# Autodesk Inventor assembly: Assembly Robot Biped
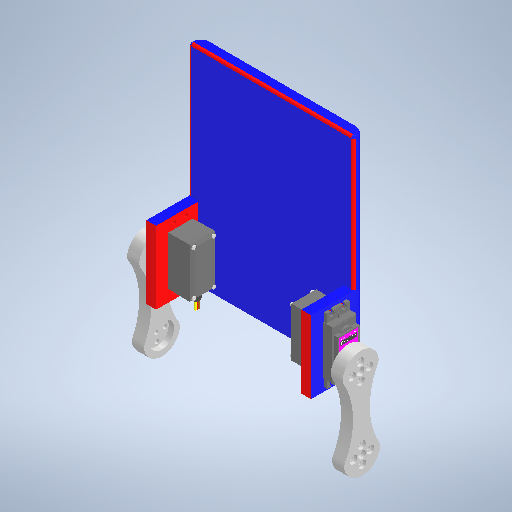
[picture p0: Inventor's stored thumbnail of the model, 512x512]
Saved by Autodesk Inventor 2025 (Build 290162000, 162)
## iProperties
Created: 2026-05-11
Part Number: Assembly Robot Biped
Document SubType Name: Assembly
Designer: novsa
Author: novsa
## Documents named in this file (5)
- C:\Users\novsa.4SUS\Downloads\Assembly Robot Biped.iam
- C:\Users\novsa.4SUS\Downloads\Project Boot camp novsa\Body Bipedal.ipt
- C:\Users\novsa.4SUS\Downloads\Project Boot camp novsa\Paha Bipedal.ipt
- C:\Users\novsa.4SUS\Downloads\Project Boot camp novsa\Motor Servo MG996R.ipt
- C:\Users\novsa.4SUS\Downloads\Project Boot camp novsa\Motor Servo MG996R_MIR1.ipt
## Components (5 placed, 4 different names)
1. Body Bipedal:1 — Rigid:1, Rigid:2
2. Paha Bipedal:1 — Rotational:2
3. Paha Bipedal:2 — Rotational:1
4. Motor Servo MG996R:3 — Rigid:2, Rotational:2
5. Motor Servo MG996R_MIR1:1 — Rigid:1, Rotational:1
## Relationships (4: WeldJoint 2, RevoluteJoint 2)
- Rigid:1 [WeldJoint]: Body Bipedal:1 ↔ Motor Servo MG996R_MIR1:1
- Rigid:2 [WeldJoint]: Body Bipedal:1 ↔ Motor Servo MG996R:3
- Rotational:1 [RevoluteJoint]: Paha Bipedal:2 ↔ Motor Servo MG996R_MIR1:1
- Rotational:2 [RevoluteJoint]: Paha Bipedal:1 ↔ Motor Servo MG996R:3
